# Autodesk Inventor assembly: MM0937AN100_G15_002
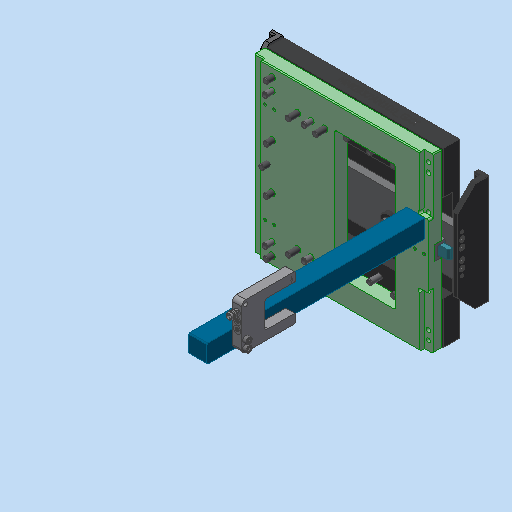
[picture p0: Inventor's stored thumbnail of the model, 512x512]
Saved by Autodesk Inventor 2023.3 (Build 273359000, 359)
## iProperties
Created: 2018-12-19
Part Number: MM0937AN100_G15_002
Document SubType Name: Assembly
Designer: Rose
Mass: 8691.2 g
Surface Area: 2951.41 cm^2
Volume: 1186.53 cm^3
Density: 7.32487 g/cm^3
AnP_Kommentar_aktuell: =<Comments>
AnP_Material_aktuell: =<Material>
Author: Rose
Revision Number: 01
## Documents named in this file (3)
- C:\Users\rea9an\Documents\Inventor\TCAI2412_te1910_EM\AS00000909.iam
- C:\Users\rea9an\Documents\Inventor\TCAI2412_te1910_EM\AS00000910.iam
- C:\Users\rea9an\Documents\Inventor\TCAI2412_te1910_EM\AS00000911.iam
## Components (2 placed, 2 different names)
1. AS00000910:1 [sub-assembly] — Passend:1, Passend:2, Fluchtend:1
2. AS00000911:1 [sub-assembly] — Passend:1, Passend:2, Fluchtend:1
## Relationships (3: Mate 2, Flush 1)
- Passend:1 [Mate] (1 mm): AS00000910:1 ↔ AS00000911:1
- Passend:2 [Mate]: AS00000910:1 ↔ AS00000911:1
- Fluchtend:1 [Flush]: AS00000910:1 ↔ AS00000911:1
